# Autodesk Inventor assembly: Assembly2
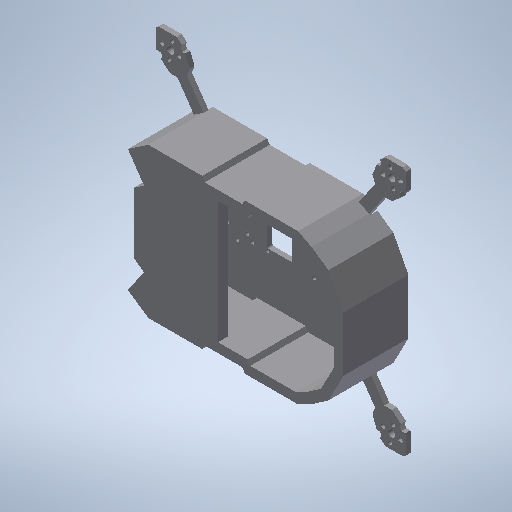
[picture p0: Inventor's stored thumbnail of the model, 512x512]
Saved by Autodesk Inventor 2025.2 (Build 292293000, 293)
## iProperties
Created: 2026-06-17
Part Number: Assembly2
Document SubType Name: Assembly
Designer: crazi
Author: crazi
## Documents named in this file (3)
- D:\Family\Arav\Projects\Drone\Chassis\Custom Chassis\Modelled\Assembly2.iam
- D:\Family\Arav\Projects\Drone\Chassis\Custom Chassis\Modelled\Base Model V2.ipt
- D:\Family\Arav\Projects\Drone\Chassis\Custom Chassis\Modelled\Bottom Cap V3 - Main V2.ipt
## Components (2 placed, 2 different names)
1. Base Model V2:1 — Mate:1, Mate:2, Mate:3
2. Bottom Cap V3 - Main V2:1 — Mate:1, Mate:2, Mate:3
## Relationships (3: Mate 3)
- Mate:1: Base Model V2:1 ↔ Bottom Cap V3 - Main V2:1
- Mate:2: Base Model V2:1 ↔ Bottom Cap V3 - Main V2:1
- Mate:3: Base Model V2:1 ↔ Bottom Cap V3 - Main V2:1
